# Autodesk Inventor assembly: Geruest_mit_30x30
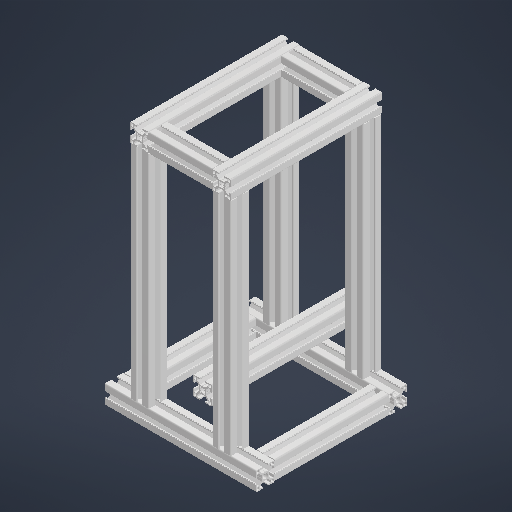
[picture p0: Inventor's stored thumbnail of the model, 512x512]
Saved by Autodesk Inventor 2027.1 (Build 311270010, 270A)
## iProperties
Created: 2026-11-12
Part Number: Geruest_mit_30x30
Document SubType Name: Assembly
Designer: nicol
Author: nicol
## Documents named in this file (5)
- C:\Worksspace2\PA_2026\Electromagnetic_Levitation_System_git\Electromagnetic_Levitation_System\04_3D_Design\Gerüst\Geruest_mit_30x30.iam
- C:\Worksspace2\PA_2026\Electromagnetic_Levitation_System_git\Electromagnetic_Levitation_System\04_3D_Design\Gerüst\30x30x240 B-Type Slot 8\30x30x240.ipt
- C:\Worksspace2\PA_2026\Electromagnetic_Levitation_System_git\Electromagnetic_Levitation_System\04_3D_Design\Gerüst\30x30x180 B-Type Slot 8\30x30x180.ipt
- C:\Worksspace2\PA_2026\Electromagnetic_Levitation_System_git\Electromagnetic_Levitation_System\04_3D_Design\Gerüst\30x30x350 B-Type Slot 8\30x30x350.ipt
- C:\Worksspace2\PA_2026\Electromagnetic_Levitation_System_git\Electromagnetic_Levitation_System\04_3D_Design\Gerüst\30x30x100 B-Type Slot 8\30x30x100.ipt
## Components (13 placed, 4 different names)
1. 30x30x240:1 — Flush:1, Mate:1, Flush:2, Mate:2, Flush:3, Flush:4, Mate:4, Mate:5, Flush:7, Flush:8, Flush:9, Flush:10
2. 30x30x240:2 — Mate:3, Flush:5, Flush:6, Mate:6, Mate:7, Flush:11, Flush:12, Flush:13, Flush:14
3. 30x30x240:3 — Flush:17, Flush:18, Mate:9, Mate:10, Mate:11
4. 30x30x240:4 — Flush:23, Mate:12
5. 30x30x240:5 — Flush:15, Flush:16, Mate:8, Flush:19, Flush:20, Flush:21, Flush:22
6. 30x30x180:1 — Flush:1, Mate:1, Flush:2, Flush:6
7. 30x30x180:2 — Mate:2, Flush:3, Flush:4, Mate:3, Flush:5
8. 30x30x350:1 — Mate:4, Flush:7, Flush:8, Flush:15, Flush:16, Mate:8, Flush:23, Mate:12
9. 30x30x350:2 — Mate:5, Flush:9, Flush:10, Flush:17, Flush:18, Mate:9
10. 30x30x350:3 — Mate:6, Flush:11, Flush:13
11. 30x30x350:4 — Mate:7, Flush:12, Flush:14
12. 30x30x100:1 — Mate:10, Flush:19, Flush:20
13. 30x30x100:2 — Mate:11, Flush:21, Flush:22
## Relationships (35: Flush 23, Mate 12)
- Flush:1: 30x30x240:1 ↔ 30x30x180:1
- Mate:1: 30x30x240:1 ↔ 30x30x180:1
- Flush:2: 30x30x240:1 ↔ 30x30x180:1
- Mate:2: 30x30x240:1 ↔ 30x30x180:2
- Flush:3: 30x30x240:1 ↔ 30x30x180:2
- Flush:4: 30x30x240:1 ↔ 30x30x180:2
- Mate:3: 30x30x240:2 ↔ 30x30x180:2
- Flush:5: 30x30x240:2 ↔ 30x30x180:2
- Flush:6: 30x30x240:2 ↔ 30x30x180:1
- Mate:4: 30x30x240:1 ↔ 30x30x350:1
- Mate:5: 30x30x240:1 ↔ 30x30x350:2
- Mate:6: 30x30x240:2 ↔ 30x30x350:3
- Mate:7: 30x30x240:2 ↔ 30x30x350:4
- Flush:7 (40 mm): 30x30x240:1 ↔ 30x30x350:1
- Flush:8: 30x30x240:1 ↔ 30x30x350:1
- Flush:9: 30x30x240:1 ↔ 30x30x350:2
- Flush:10 (40 mm): 30x30x240:1 ↔ 30x30x350:2
- Flush:11: 30x30x240:2 ↔ 30x30x350:3
- Flush:12: 30x30x240:2 ↔ 30x30x350:4
- Flush:13 (40 mm): 30x30x240:2 ↔ 30x30x350:3
- Flush:14 (40 mm): 30x30x240:2 ↔ 30x30x350:4
- Flush:15: 30x30x240:5 ↔ 30x30x350:1
- Flush:16: 30x30x240:5 ↔ 30x30x350:1
- Flush:17: 30x30x240:3 ↔ 30x30x350:2
- Flush:18: 30x30x240:3 ↔ 30x30x350:2
- Mate:8: 30x30x240:5 ↔ 30x30x350:1
- Mate:9: 30x30x240:3 ↔ 30x30x350:2
- Mate:10: 30x30x240:3 ↔ 30x30x100:1
- Mate:11: 30x30x240:3 ↔ 30x30x100:2
- Flush:19: 30x30x240:5 ↔ 30x30x100:1
- Flush:20: 30x30x240:5 ↔ 30x30x100:1
- Flush:21: 30x30x240:5 ↔ 30x30x100:2
- Flush:22: 30x30x240:5 ↔ 30x30x100:2
- Flush:23: 30x30x240:4 ↔ 30x30x350:1
- Mate:12: 30x30x240:4 ↔ 30x30x350:1
